# Autodesk Inventor assembly: ThighLink_Active_Left_Assembly
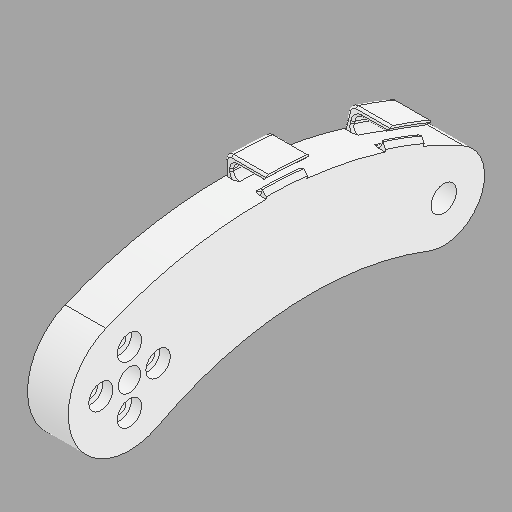
[picture p0: Inventor's stored thumbnail of the model, 512x512]
Saved by Autodesk Inventor 2025 (Build 290162000, 162)
## iProperties
Created: 2024-11-15
Part Number: ThighLink_Active_Left_Assembly
Document SubType Name: Assembly
Designer: OSB
Mass: 42.4199 g
Surface Area: 155.887 cm^2
Volume: 31.6886 cm^3
Density: 1.33865 g/cm^3
Sending System: Autodesk Inventor 2021
Preprocessor: unknown
Minimum Resolution: 0.01
Sent Units: Millimeter
Translation Standard: IGES 5.3
Model Creation Time: 2020-07-07
Title: S500 Frame
Author: OSB
## Documents named in this file (9)
- C:\Users\OSB\Desktop\SB\1.Projects\캡스톤 디자인(2)_Paper\Modeling\Implementation_Design\Ver_003_mass_update\ThighLink_Active_Left_Assembly_Collision.iam
- C:\Users\OSB\Desktop\SB\1.Projects\캡스톤 디자인(2)_Paper\Modeling\Implementation_Design\Ver_003_mass_update\ThighLink_Active_Left.ipt
- C:\Users\OSB\Desktop\SB\1.Projects\캡스톤 디자인(2)_Paper\Modeling\Implementation_Design\Ver_003_mass_update\ServoHorn_Hip.ipt
- C:\Users\OSB\Desktop\SB\1.Projects\캡스톤 디자인(2)_Paper\Modeling\Implementation_Design\Ver_003_mass_update\ShoulderBolt.ipt
- C:\Users\OSB\Documents\Inventor\Content Center Files\R2025\ko-KR\KS B 1003\KS B 1003 - M 3 x 10.ipt
- C:\Users\OSB\Desktop\SB\1.Projects\캡스톤 디자인(2)_Paper\Modeling\Implementation_Design\Ver_003_mass_update\Washer_6x12.5x1.ipt
- C:\Users\OSB\Documents\Inventor\Content Center Files\R2025\ko-KR\KS B 2023\KS B 2023 - 696 - 6 x 15 x 5 - 1.132.ipt
- C:\Users\OSB\Desktop\SB\1.Projects\캡스톤 디자인(2)_Paper\Modeling\Implementation_Design\Ver_003_mass_update\Spacer_Joint_Assembly.ipt.iam
- Spacer_Joint_Assembly.ipt
## Components (12 placed, 7 different names)
1. ThighLink_Active_Left:1 — 회전:1, 메이트:1, 강체:1, 삽입:1, 삽입:2, 삽입:3, 삽입:4, 회전:2
2. ServoHorn_Hip:1 — 회전:1, 메이트:1
3. ShoulderBolt:1 — 강체:1
4. KS B 1003 - 미터 M 3 x 10:1 — 삽입:1
5. KS B 1003 - 미터 M 3 x 10:2 — 삽입:2
6. KS B 1003 - 미터 M 3 x 10:3 — 삽입:3
7. KS B 1003 - 미터 M 3 x 10:4 — 삽입:4
8. Washer_6x12.5x1:1 — 강체:4, 회전:2
9. Washer_6x12.5x1:2 — 강체:3, 강체:5
10. KS B 2023 696 - 6 x 15 x 5:1 — 강체:2, 강체:3
11. KS B 2023 696 - 6 x 15 x 5:2 — 강체:2, 강체:4
12. Spacer_Joint_Assembly.ipt:1 [sub-assembly] — 강체:5
## Relationships (12: WeldJoint 5, Insert 4, RevoluteJoint 2, Mate 1)
- 회전:1 [RevoluteJoint]: ThighLink_Active_Left:1 ↔ ServoHorn_Hip:1
- 메이트:1 [Mate]: ThighLink_Active_Left:1 ↔ ServoHorn_Hip:1
- 강체:1 [WeldJoint]: ThighLink_Active_Left:1 ↔ ShoulderBolt:1
- 삽입:1 [Insert]: ThighLink_Active_Left:1 ↔ KS B 1003 - 미터 M 3 x 10:1
- 삽입:2 [Insert]: ThighLink_Active_Left:1 ↔ KS B 1003 - 미터 M 3 x 10:2
- 삽입:3 [Insert]: ThighLink_Active_Left:1 ↔ KS B 1003 - 미터 M 3 x 10:3
- 삽입:4 [Insert]: ThighLink_Active_Left:1 ↔ KS B 1003 - 미터 M 3 x 10:4
- 강체:2 [WeldJoint]: KS B 2023 696 - 6 x 15 x 5:1 ↔ KS B 2023 696 - 6 x 15 x 5:2
- 강체:3 [WeldJoint]: Washer_6x12.5x1:2 ↔ KS B 2023 696 - 6 x 15 x 5:1
- 강체:4 [WeldJoint]: Washer_6x12.5x1:1 ↔ KS B 2023 696 - 6 x 15 x 5:2
- 회전:2 [RevoluteJoint]: ThighLink_Active_Left:1 ↔ Washer_6x12.5x1:1
- 강체:5 [WeldJoint]: Washer_6x12.5x1:2 ↔ Spacer_Joint_Assembly.ipt:1
